# Autodesk Inventor assembly: taladro_uwu
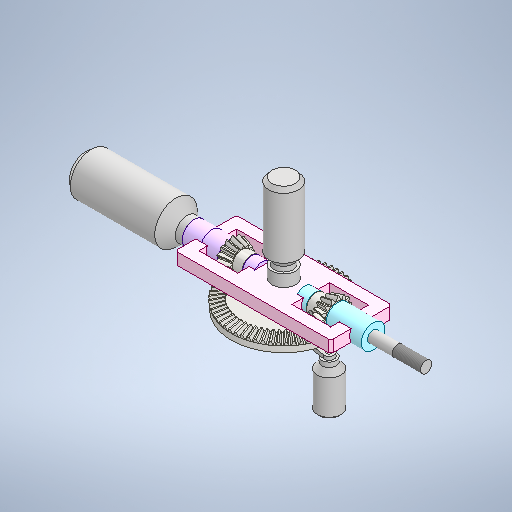
[picture p0: Inventor's stored thumbnail of the model, 512x512]
Saved by Autodesk Inventor 2025.2 (Build 292293000, 293)
## iProperties
Created: 2025-03-20
Part Number: taladro_uwu
Document SubType Name: Assembly
Designer: laura
Author: laura
## Documents named in this file (22)
- C:\Users\laura\OneDrive - Universidad de los andes\Documentos\7mo semestre\Principios de Mecanizado\taladro_uwu.iam
- C:\Users\laura\OneDrive - Universidad de los andes\Documentos\7mo semestre\Principios de Mecanizado\base.ipt
- C:\Users\laura\OneDrive - Universidad de los andes\Documentos\7mo semestre\Principios de Mecanizado\cilindro_base.ipt
- C:\Users\laura\OneDrive - Universidad de los andes\Documentos\7mo semestre\Principios de Mecanizado\cilindro_ext_interferencia.ipt
- C:\Users\laura\OneDrive - Universidad de los andes\Documentos\7mo semestre\Principios de Mecanizado\cilindro_ext_pasante.ipt
- C:\Users\laura\OneDrive - Universidad de los andes\Documentos\7mo semestre\Principios de Mecanizado\cilindro_int_interferencia.ipt
- C:\Users\laura\OneDrive - Universidad de los andes\Documentos\7mo semestre\Principios de Mecanizado\cilindro_int_pasante.ipt
- C:\Users\laura\OneDrive - Universidad de los andes\Documentos\7mo semestre\Principios de Mecanizado\mango_1.ipt
- C:\Users\laura\OneDrive - Universidad de los andes\Documentos\7mo semestre\Principios de Mecanizado\mango_2.ipt
- C:\Users\laura\OneDrive - Universidad de los andes\Documentos\7mo semestre\Principios de Mecanizado\mango_3.ipt
- C:\Users\laura\OneDrive - Universidad de los andes\Documentos\7mo semestre\Principios de Mecanizado\manivela_p1.ipt
- C:\Users\laura\OneDrive - Universidad de los andes\Documentos\7mo semestre\Principios de Mecanizado\eje_mandril.ipt
- C:\Users\laura\OneDrive - Universidad de los andes\Documentos\7mo semestre\Principios de Mecanizado\eje_interferencia.ipt
- C:\Users\laura\OneDrive - Universidad de los andes\Documentos\7mo semestre\Principios de Mecanizado\rosca_mango2.ipt
- C:\Users\laura\OneDrive - Universidad de los andes\Documentos\7mo semestre\Principios de Mecanizado\rosca_mango1.ipt
- C:\Users\laura\OneDrive - Universidad de los andes\Documentos\7mo semestre\Principios de Mecanizado\eje_manivela.ipt
- C:\Users\laura\OneDrive - Universidad de los andes\Documentos\7mo semestre\Principios de Mecanizado\eje_piñon_fijo.ipt
- C:\Users\laura\Documents\Inventor\Content Center Files\R2025\en-US\AS 1427(01)\AS 1427 - M6 x 25(3).ipt
- C:\Users\laura\Documents\Inventor\Content Center Files\R2025\en-US\AS 1427(01)\AS 1427 - M3.5 x 12(3).ipt
- C:\Users\laura\OneDrive - Universidad de los andes\Documentos\7mo semestre\Principios de Mecanizado\Corona_piñones2\Design Accelerator\Bevel Gear21.ipt
- C:\Users\laura\OneDrive - Universidad de los andes\Documentos\7mo semestre\Principios de Mecanizado\Corona_piñones2\Design Accelerator\Piñon_fijo.ipt
- C:\Users\laura\OneDrive - Universidad de los andes\Documentos\7mo semestre\Principios de Mecanizado\Corona_piñones2\Design Accelerator\Piñon_libre.ipt
## Components (21 placed, 20 different names)
1. base:1 — Mate:22, Rigid:13, Rigid:15, Rigid:16, Rigid:17, Mate:27, Mate:28, Rigid:18
2. cilindro_base:1 — Mate:28, Rigid:18, Rotational:20, Rigid:22, Rigid:23
3. cilindro_ext_interferencia:1 — Rigid:13, Rigid:24, Rigid:25
4. cilindro_ext_pasante:1 — Rigid:16
5. cilindro_int_interferencia:1 — Rigid:14, Rigid:15
6. cilindro_int_pasante:1 — Rotational:3, Rigid:17
7. mango_1:1 — Rigid:25
8. mango_2:1 — Rigid:23
9. mango_3:1 — Mate:21, Flush:1, Rigid:21
10. manivela_p1:1 — Mate:31, Mate:32, Mate:33, Rigid:21, Rigid:27
11. eje_mandril:1 — Rotational:3, Mate:29, Mate:30, Rigid:20
12. eje_interferencia:1 — Rigid:14
13. rosca_mango2:1 — Rigid:22
14. rosca_mango1:1 — Rigid:24
15. eje_manivela:1 — Mate:21, Flush:1
16. eje_piñon_fijo:1 — Rigid:20
17. AS 1427 - Metric M6 x 25:1 — Rigid:26
18. AS 1427 - Metric M3.5 x 12:1 — Rigid:27
19. Bevel Gear2:2 — Mate:22, Mate:26, Mate:27, Rotational:20, Mate:31, Mate:32, Mate:33, Rigid:26
20. Bevel Gear1:3 — Mate:29, Mate:30
21. Bevel Gear1:4 — Mate:26
## Relationships (27: WeldJoint 14, Mate 10, RevoluteJoint 2, Flush 1)
- Rotational:3 [RevoluteJoint]: cilindro_int_pasante:1 ↔ eje_mandril:1
- Mate:21: mango_3:1 ↔ eje_manivela:1
- Flush:1: mango_3:1 ↔ eje_manivela:1
- Mate:22: base:1 ↔ Bevel Gear2:2
- Mate:26: Bevel Gear2:2 ↔ Bevel Gear1:4
- Rigid:13 [WeldJoint]: base:1 ↔ cilindro_ext_interferencia:1
- Rigid:14 [WeldJoint]: cilindro_int_interferencia:1 ↔ eje_interferencia:1
- Rigid:15 [WeldJoint]: base:1 ↔ cilindro_int_interferencia:1
- Rigid:16 [WeldJoint]: base:1 ↔ cilindro_ext_pasante:1
- Rigid:17 [WeldJoint]: base:1 ↔ cilindro_int_pasante:1
- Mate:27: base:1 ↔ Bevel Gear2:2
- Mate:28: base:1 ↔ cilindro_base:1
- Rigid:18 [WeldJoint]: base:1 ↔ cilindro_base:1
- Rotational:20 [RevoluteJoint]: cilindro_base:1 ↔ Bevel Gear2:2
- Mate:29: eje_mandril:1 ↔ Bevel Gear1:3
- Mate:30: eje_mandril:1 ↔ Bevel Gear1:3
- Rigid:20 [WeldJoint]: eje_mandril:1 ↔ eje_piñon_fijo:1
- Mate:31: manivela_p1:1 ↔ Bevel Gear2:2
- Mate:32: manivela_p1:1 ↔ Bevel Gear2:2
- Mate:33: manivela_p1:1 ↔ Bevel Gear2:2
- Rigid:21 [WeldJoint]: mango_3:1 ↔ manivela_p1:1
- Rigid:22 [WeldJoint]: cilindro_base:1 ↔ rosca_mango2:1
- Rigid:23 [WeldJoint]: cilindro_base:1 ↔ mango_2:1
- Rigid:24 [WeldJoint]: cilindro_ext_interferencia:1 ↔ rosca_mango1:1
- Rigid:25 [WeldJoint]: cilindro_ext_interferencia:1 ↔ mango_1:1
- Rigid:26 [WeldJoint]: AS 1427 - Metric M6 x 25:1 ↔ Bevel Gear2:2
- Rigid:27 [WeldJoint]: manivela_p1:1 ↔ AS 1427 - Metric M3.5 x 12:1
